(part 1 of 5)
# Autodesk Inventor assembly: ASSEMBLY_DUT_Ant_Rotator_REVB
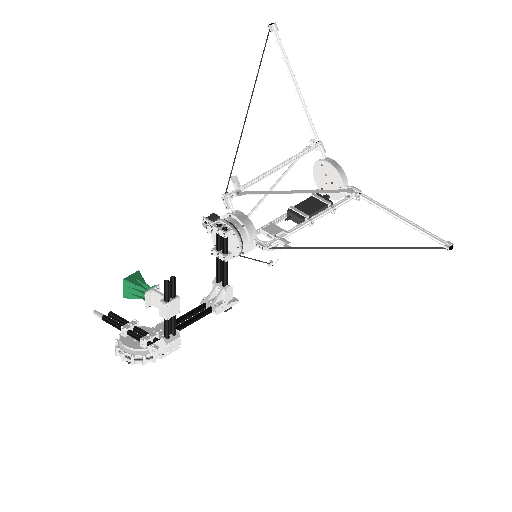
[picture p0: Inventor's stored thumbnail of the model, 512x512]
Saved by Autodesk Inventor 2027 (Build 310192060, 192F)
## iProperties
Created: 2026-01-06
Part Number: ASSEMBLY_DUT_Ant_Rotator_REVB
Document SubType Name: Assembly
Designer: User
Author: User
## Documents named in this file (105)
- C:\Users\lacze\OneDrive\_DRIVE_SYNCH_FILES\RF - Antenna Positioner\MCAD\1_V1\ASSEMBLY_DUT_ANT_POSITIONER_REVB\ASSEMBLY_DUT_Ant_Positioner_REVB.iam
- C:\Users\lacze\OneDrive\_DRIVE_SYNCH_FILES\RF - Antenna Positioner\MCAD\1_V1\__COTS_PARTS\COTS_CARBONCENTER_Fiberglass_Tube_27x24x383mm.ipt
- C:\Users\lacze\OneDrive\_DRIVE_SYNCH_FILES\RF - Antenna Positioner\MCAD\1_V1\__COTS_PARTS\COTS_GENERIC_6020_2RS_150x100x24mm_Ball_Bearing\COTS_GENERIC_6020_2RS_150x100x24mm_Ball_Bearing.ipt
- C:\Users\lacze\OneDrive\_DRIVE_SYNCH_FILES\RF - Antenna Positioner\MCAD\1_V1\ASSEMBLY_DUT_ANT_POSITIONER_REVA\3DP_PLA_A_Axis_Bearing_Base.ipt
- C:\Users\lacze\OneDrive\_DRIVE_SYNCH_FILES\RF - Antenna Positioner\MCAD\1_V1\ASSEMBLY_DUT_ANT_POSITIONER_REVA\3DP_PLA_A_Axis_Bearing_Base_Bearing_Locking_Ring.ipt
- C:\Users\lacze\OneDrive\_DRIVE_SYNCH_FILES\RF - Antenna Positioner\MCAD\1_V1\__CONTENT_CENTER_PARTS\en-US\ISO 7380-1\ISO 7380-1 - M4 x 40.ipt
- C:\Users\lacze\OneDrive\_DRIVE_SYNCH_FILES\RF - Antenna Positioner\MCAD\1_V1\__CONTENT_CENTER_PARTS\en-US\DIN 934\DIN 934 - M4 x 0,7.ipt
- C:\Users\lacze\OneDrive\_DRIVE_SYNCH_FILES\RF - Antenna Positioner\MCAD\1_V1\ASSEMBLY_DUT_ANT_POSITIONER_REVA\3DP_PLA_A_Axis_Rotating_Stage.ipt
- C:\Users\lacze\OneDrive\_DRIVE_SYNCH_FILES\RF - Antenna Positioner\MCAD\1_V1\ASSEMBLY_DUT_ANT_POSITIONER_REVA\3DP_PLA_A_Axis_Rotating_Stage_Mounting_Plate.ipt
- C:\Users\lacze\OneDrive\_DRIVE_SYNCH_FILES\RF - Antenna Positioner\MCAD\1_V1\__CONTENT_CENTER_PARTS\en-US\DIN 912\DIN 912 - M5 x 0,8 x 50 x 22.ipt
- C:\Users\lacze\OneDrive\_DRIVE_SYNCH_FILES\RF - Antenna Positioner\MCAD\1_V1\__CONTENT_CENTER_PARTS\en-US\DIN 934\DIN 934 - M5 x 0,8.ipt
- C:\Users\lacze\OneDrive\_DRIVE_SYNCH_FILES\RF - Antenna Positioner\MCAD\1_V1\__COTS_PARTS\COTS_GENERIC_HTD3M_24T_6mm_5mm_shaft_pulley.ipt
- C:\Users\lacze\OneDrive\_DRIVE_SYNCH_FILES\RF - Antenna Positioner\MCAD\1_V1\__COTS_PARTS\COTS_GENERIC_HTD3M_6mm_675mm_Closed_belt_A_Axis.ipt
- C:\Users\lacze\OneDrive\_DRIVE_SYNCH_FILES\RF - Antenna Positioner\MCAD\1_V1\ASSEMBLY_DUT_ANT_POSITIONER_REVA\ASSEMBLY_HTD3M_Idler_A_Axis.iam
- C:\Users\lacze\OneDrive\_DRIVE_SYNCH_FILES\RF - Antenna Positioner\MCAD\1_V1\__CONTENT_CENTER_PARTS\en-US\DIN 125-1  A\DIN 125 - A 3,2.ipt
- C:\Users\lacze\OneDrive\_DRIVE_SYNCH_FILES\RF - Antenna Positioner\MCAD\1_V1\__CONTENT_CENTER_PARTS\en-US\ISO 7380-1\ISO 7380-1 - M3 x 16.ipt
- C:\Users\lacze\OneDrive\_DRIVE_SYNCH_FILES\RF - Antenna Positioner\MCAD\1_V1\ASSEMBLY_DUT_ANT_POSITIONER_REVA\3DP_PLA_A_Axis_Rotating_Stage_Fiberglass_pipes_mount_plate.ipt
- C:\Users\lacze\OneDrive\_DRIVE_SYNCH_FILES\RF - Antenna Positioner\MCAD\1_V1\ASSEMBLY_DUT_ANT_POSITIONER_REVA\3DP_PLA_A_Axis_Rotating_Stage_Fiberglass_pipes_mount_clamp.ipt
- C:\Users\lacze\OneDrive\_DRIVE_SYNCH_FILES\RF - Antenna Positioner\MCAD\1_V1\__CONTENT_CENTER_PARTS\en-US\DIN 912\DIN 912 - M4 x 0,7 x 20 x 18,25.ipt
- C:\Users\lacze\OneDrive\_DRIVE_SYNCH_FILES\RF - Antenna Positioner\MCAD\1_V1\__COTS_PARTS\COTS_MKS_SERVO42D_40mm.ipt
- C:\Users\lacze\OneDrive\_DRIVE_SYNCH_FILES\RF - Antenna Positioner\MCAD\1_V1\ASSEMBLY_DUT_ANT_POSITIONER_REVA\3DP_PLA_Fiberglass_Pipe_Corner_Bracket.ipt
- C:\Users\lacze\OneDrive\_DRIVE_SYNCH_FILES\RF - Antenna Positioner\MCAD\1_V1\ASSEMBLY_DUT_ANT_POSITIONER_REVA\3DP_PLA_Fiberglass_Pipe_Corner_Bracket_Clamp.ipt
- C:\Users\lacze\OneDrive\_DRIVE_SYNCH_FILES\RF - Antenna Positioner\MCAD\1_V1\__COTS_PARTS\COTS_DREMEC_8G206M6X50_M6x50_Nylon_Screw.ipt
- COTS_DREMEC_8G206M6X50_M6x50_Nylon_Screw.ipt
- C:\Users\lacze\OneDrive\_DRIVE_SYNCH_FILES\RF - Antenna Positioner\MCAD\1_V1\__COTS_PARTS\COTS_BOSSARD_1400444_M6_Nylon_Nut.ipt
- C:\Users\lacze\OneDrive\_DRIVE_SYNCH_FILES\RF - Antenna Positioner\MCAD\1_V1\__COTS_PARTS\COTS_GENERIC_HTD3M_20T_6mm_5mm_shaft_pulley.ipt
- C:\Users\lacze\OneDrive\_DRIVE_SYNCH_FILES\RF - Antenna Positioner\MCAD\1_V1\ASSEMBLY_DUT_ANT_POSITIONER_REVA\3DP_PLA_B_Axis_Main_Pulley.ipt
- C:\Users\lacze\OneDrive\_DRIVE_SYNCH_FILES\RF - Antenna Positioner\MCAD\1_V1\ASSEMBLY_DUT_ANT_POSITIONER_REVA\ASSEMBLY_HTD3M_Idler_B_Axis.iam
- C:\Users\lacze\OneDrive\_DRIVE_SYNCH_FILES\RF - Antenna Positioner\MCAD\1_V1\__COTS_PARTS\COTS_GENERIC_HTD3M_6mm_1530mm_Closed_belt_B_Axis.ipt
- C:\Users\lacze\OneDrive\_DRIVE_SYNCH_FILES\RF - Antenna Positioner\MCAD\1_V1\__CONTENT_CENTER_PARTS\en-US\DIN 912\DIN 912 - M4 x 0,7 x 35 x 20.ipt
- C:\Users\lacze\OneDrive\_DRIVE_SYNCH_FILES\RF - Antenna Positioner\MCAD\1_V1\__COTS_PARTS\COTS_GENERIC_6016_80x125x22mm_POM_Ball_Bearing\COTS_GENERIC_6016_80x125x22mm_POM_Ball_Bearing.ipt
- C:\Users\lacze\OneDrive\_DRIVE_SYNCH_FILES\RF - Antenna Positioner\MCAD\1_V1\ASSEMBLY_DUT_ANT_POSITIONER_REVA\3DP_PLA_B_Axis_Bearing_Mounting_Plate.ipt
- C:\Users\lacze\OneDrive\_DRIVE_SYNCH_FILES\RF - Antenna Positioner\MCAD\1_V1\ASSEMBLY_DUT_ANT_POSITIONER_REVA\ASSEMBLY_HTD3M_Idler_B_Axis_Top.iam
- C:\Users\lacze\OneDrive\_DRIVE_SYNCH_FILES\RF - Antenna Positioner\MCAD\1_V1\__COTS_PARTS\COTS_DREMEC_8G206V50126_M4x40_Nylon_Screw.ipt
- C:\Users\lacze\OneDrive\_DRIVE_SYNCH_FILES\RF - Antenna Positioner\MCAD\1_V1\__COTS_PARTS\COTS_BOSSARD_1400428_M4_Nylon_Nut.ipt
- C:\Users\lacze\OneDrive\_DRIVE_SYNCH_FILES\RF - Antenna Positioner\MCAD\1_V1\ASSEMBLY_DUT_ANT_POSITIONER_REVA\3DP_PLA_B_Axis_Rotating_Stage.ipt
- C:\Users\lacze\OneDrive\_DRIVE_SYNCH_FILES\RF - Antenna Positioner\MCAD\1_V1\__COTS_PARTS\COTS_BYTECHLAB_COAXIAL_FEED_HORN\COTS_BYTECHLAB_Coaxial_Feed_Horn.iam
- C:\Users\lacze\OneDrive\_DRIVE_SYNCH_FILES\RF - Antenna Positioner\MCAD\1_V1\ASSEMBLY_DUT_ANT_POSITIONER_REVA\3DP_PLA_B_Axis_Rotating_Stage_Fiberglass_pipes_mount_clamp.ipt
- C:\Users\lacze\OneDrive\_DRIVE_SYNCH_FILES\RF - Antenna Positioner\MCAD\1_V1\ASSEMBLY_DUT_ANT_POSITIONER_REVA\3DP_PLA_B_Axis_End_Cap.ipt
- C:\Users\lacze\OneDrive\_DRIVE_SYNCH_FILES\RF - Antenna Positioner\MCAD\1_V1\ASSEMBLY_DUT_ANT_POSITIONER_REVA\3DP_PLA_Antenna_Boom_Fiberglass_Pipe_Clamp.ipt
- C:\Users\lacze\OneDrive\_DRIVE_SYNCH_FILES\RF - Antenna Positioner\MCAD\1_V1\__COTS_PARTS\COTS_Profihot_HC-2-22x16_Zip_Tie_Anchor.ipt
- C:\Users\lacze\OneDrive\_DRIVE_SYNCH_FILES\RF - Antenna Positioner\MCAD\1_V1\__COTS_PARTS\COTS_BOSSARD_1386883_M4_Threaded_Insert\COTS_BOSSARD_1386883_M4_Threaded_Insert.ipt
- C:\Users\lacze\OneDrive\_DRIVE_SYNCH_FILES\RF - Antenna Positioner\MCAD\1_V1\__CONTENT_CENTER_PARTS\en-US\DIN 125-1  A\DIN 125 - A 4,3.ipt
- C:\Users\lacze\OneDrive\_DRIVE_SYNCH_FILES\RF - Antenna Positioner\MCAD\1_V1\__CONTENT_CENTER_PARTS\en-US\ISO 7380-1\ISO 7380-1 - M4 x 8.ipt
- C:\Users\lacze\OneDrive\_DRIVE_SYNCH_FILES\RF - Antenna Positioner\MCAD\1_V1\__CONTENT_CENTER_PARTS\en-US\ISO 7380-1\ISO 7380-1 - M4 x 16.ipt
- C:\Users\lacze\OneDrive\_DRIVE_SYNCH_FILES\RF - Antenna Positioner\MCAD\1_V1\__COTS_PARTS\COTS_DREMEC_8G206M5X08_M5x8_Nylon_Screw.ipt
- C:\Users\lacze\OneDrive\_DRIVE_SYNCH_FILES\RF - Antenna Positioner\MCAD\1_V1\ASSEMBLY_DUT_ANT_POSITIONER_REVA\3DP_PLA_B_Axis_Cable_Galnd.ipt
- C:\Users\lacze\OneDrive\_DRIVE_SYNCH_FILES\RF - Antenna Positioner\MCAD\1_V1\ASSEMBLY_DUT_ANT_POSITIONER_REVA\3DP_PLA_A_Axis_Idler_Stiffening_Bracket.ipt
- C:\Users\lacze\OneDrive\_DRIVE_SYNCH_FILES\RF - Antenna Positioner\MCAD\1_V1\ASSEMBLY_DUT_ANT_POSITIONER_REVA\3DP_PLA_B_Axis_Idler_Stiffening_Bracket.ipt
- C:\Users\lacze\OneDrive\_DRIVE_SYNCH_FILES\RF - Antenna Positioner\MCAD\1_V1\ASSEMBLY_DUT_ANT_POSITIONER_REVB\3DP_PLA_Antenna_Boom_Coax_Feed_Horn_REVB.ipt
- C:\Users\lacze\OneDrive\_DRIVE_SYNCH_FILES\RF - Antenna Positioner\MCAD\1_V1\ASSEMBLY_DUT_ANT_POSITIONER_REVB\3DP_PLA_A_Axis_Bearing_Base_Stand_Mount_REVB.ipt
- C:\Users\lacze\OneDrive\_DRIVE_SYNCH_FILES\RF - Antenna Positioner\MCAD\1_V1\__COTS_PARTS\COTS_Fleximo_FB12020_20x20_Alu_Profile_150mm.ipt
- C:\Users\lacze\OneDrive\_DRIVE_SYNCH_FILES\RF - Antenna Positioner\MCAD\1_V1\__COTS_PARTS\COTS_Fleximo_FB12020_20x20_Alu_Profile_600mm.ipt
- C:\Users\lacze\OneDrive\_DRIVE_SYNCH_FILES\RF - Antenna Positioner\MCAD\1_V1\__COTS_PARTS\COTS_Fleximo_FB1K2020_Angle\COTS_Fleximo_FB1K2020_Angle.ipt
- C:\Users\lacze\OneDrive\_DRIVE_SYNCH_FILES\RF - Antenna Positioner\MCAD\1_V1\__COTS_PARTS\COTS_Fleximo_FB1ZP20C_20x20_End_Cap\COTS_Fleximo_FB1ZP20C_20x20_End_Cap.ipt
- C:\Users\lacze\OneDrive\_DRIVE_SYNCH_FILES\RF - Antenna Positioner\MCAD\1_V1\__COTS_PARTS\COTS_Fleximo_FB12020_20x20_Alu_Profile_575mm.ipt
- C:\Users\lacze\OneDrive\_DRIVE_SYNCH_FILES\RF - Antenna Positioner\MCAD\1_V1\__COTS_PARTS\COTS_Fleximo_FBP2020_20x20_Hinge\COTS_Fleximo_FBP2020_20x20_Hinge.ipt
- C:\Users\lacze\OneDrive\_DRIVE_SYNCH_FILES\RF - Antenna Positioner\MCAD\1_V1\__COTS_PARTS\COTS_GENERIC_5mm_Carbon_Rod.ipt
- C:\Users\lacze\OneDrive\_DRIVE_SYNCH_FILES\RF - Antenna Positioner\MCAD\1_V1\__COTS_PARTS\COTS_Fleximo_FB1NM3_M3_Nut_20x20\COTS_Fleximo_FB1NM3_M3_Nut_20x20.ipt
- C:\Users\lacze\OneDrive\_DRIVE_SYNCH_FILES\RF - Antenna Positioner\MCAD\1_V1\__CONTENT_CENTER_PARTS\en-US\ISO 7380-1\ISO 7380-1 - M3 x 12.ipt
- C:\Users\lacze\OneDrive\_DRIVE_SYNCH_FILES\RF - Antenna Positioner\MCAD\1_V1\__CONTENT_CENTER_PARTS\en-US\DIN 125-1  A\DIN 125 - A 5,3.ipt
- C:\Users\lacze\OneDrive\_DRIVE_SYNCH_FILES\RF - Antenna Positioner\MCAD\1_V1\__CONTENT_CENTER_PARTS\en-US\DIN 912\DIN 912 - M5 x 0,8 x 30 x 22.ipt
- C:\Users\lacze\OneDrive\_DRIVE_SYNCH_FILES\RF - Antenna Positioner\MCAD\1_V1\ASSEMBLY_DUT_ANT_POSITIONER_REVB\3DP_PLA_A_Axis_Bearing_Base_Stand_Mount_Bottom_REVB.ipt
- C:\Users\lacze\OneDrive\_DRIVE_SYNCH_FILES\RF - Antenna Positioner\MCAD\1_V1\__COTS_PARTS\COTS_Fleximo_FB1NM4_M4_Nut_20x20\COTS_Fleximo_FB1NM4_M4_Nut_20x20.ipt
- C:\Users\lacze\OneDrive\_DRIVE_SYNCH_FILES\RF - Antenna Positioner\MCAD\1_V1\__CONTENT_CENTER_PARTS\en-US\DIN 912\DIN 912 - M4 x 0,7 x 10 x 8,25.ipt
- C:\Users\lacze\OneDrive\_DRIVE_SYNCH_FILES\RF - Antenna Positioner\MCAD\1_V1\__CONTENT_CENTER_PARTS\en-US\DIN 912\DIN 912 - M4 x 0,7 x 16 x 14,25.ipt
- C:\Users\lacze\OneDrive\_DRIVE_SYNCH_FILES\RF - Antenna Positioner\MCAD\1_V1\ASSEMBLY_DUT_ANT_POSITIONER_REVB\3DP_PLA_A_Axis_Bearing_Base_Stand_Bottom_Plate_REVB.ipt
- C:\Users\lacze\OneDrive\_DRIVE_SYNCH_FILES\RF - Antenna Positioner\MCAD\1_V1\ASSEMBLY_DUT_ANT_POSITIONER_REVB\3DP_PLA_Foldable_Leg_Brace_Mount_REVB.ipt
- C:\Users\lacze\OneDrive\_DRIVE_SYNCH_FILES\RF - Antenna Positioner\MCAD\1_V1\ASSEMBLY_DUT_ANT_POSITIONER_REVB\3DP_PLA_A_Axis_Stepper_Mount_REVB.ipt
- C:\Users\lacze\OneDrive\_DRIVE_SYNCH_FILES\RF - Antenna Positioner\MCAD\1_V1\__COTS_PARTS\COTS_GENERIC_24V_Power_Brick.ipt
- C:\Users\lacze\OneDrive\_DRIVE_SYNCH_FILES\RF - Antenna Positioner\MCAD\1_V1\ASSEMBLY_DUT_ANT_POSITIONER_REVB\3DP_PLA_Power_Brick_Mounting_Clamp_REVB.ipt
- C:\Users\lacze\OneDrive\_DRIVE_SYNCH_FILES\RF - Antenna Positioner\MCAD\1_V1\ASSEMBLY_DUT_ANT_POSITIONER_REVB\3DP_PLA_Fiberglass_Pipe_Corner_Bracket_Clamp_and_B_axis_Stepper_Mount_REVB.ipt
- C:\Users\lacze\OneDrive\_DRIVE_SYNCH_FILES\RF - Antenna Positioner\MCAD\1_V1\ASSEMBLY_DUT_ANT_POSITIONER_REVB\3DP_PLA_Alu_Frame_Brace_REVB.ipt
- C:\Users\lacze\OneDrive\_DRIVE_SYNCH_FILES\RF - Antenna Positioner\MCAD\1_V1\ASSEMBLY_DUT_ANT_POSITIONER_REVB\LC_3mm_ALU_Alu_Frame_Brace_REVB.ipt
- C:\Users\lacze\OneDrive\_DRIVE_SYNCH_FILES\RF - Antenna Positioner\MCAD\1_V1\__CONTENT_CENTER_PARTS\en-US\DIN 912\DIN 912 - M4 x 0,7 x 25 x 23,25.ipt
- C:\Users\lacze\OneDrive\_DRIVE_SYNCH_FILES\RF - Antenna Positioner\MCAD\1_V1\ASSEMBLY_DUT_ANT_POSITIONER_REVB\3DP_PLA_Folded_Leg_Holder_REVB.ipt
- C:\Users\lacze\OneDrive\_DRIVE_SYNCH_FILES\RF - Antenna Positioner\MCAD\1_V1\ASSEMBLY_DUT_ANT_POSITIONER_REVB\3DP_PLA_Carbon_Rod_Holder_Top_REVB.ipt
- C:\Users\lacze\OneDrive\_DRIVE_SYNCH_FILES\RF - Antenna Positioner\MCAD\1_V1\ASSEMBLY_DUT_ANT_POSITIONER_REVB\3DP_PLA_Carbon_Rod_Holder_Bottom_REVB.ipt
- C:\Users\lacze\OneDrive\_DRIVE_SYNCH_FILES\RF - Antenna Positioner\MCAD\1_V1\ASSEMBLY_DUT_ANT_POSITIONER_REVB\3DP_PLA_Frame_Stiffener_and_Leg_REVB.ipt
- C:\Users\lacze\OneDrive\_DRIVE_SYNCH_FILES\RF - Antenna Positioner\MCAD\1_V1\__CONTENT_CENTER_PARTS\en-US\ISO 7380-1\ISO 7380-1 - M6 x 16.ipt
- C:\Users\lacze\OneDrive\_DRIVE_SYNCH_FILES\RF - Antenna Positioner\MCAD\1_V1\__CONTENT_CENTER_PARTS\en-US\ISO 7380-1\ISO 7380-1 - M5 x 8.ipt
- C:\Users\lacze\OneDrive\_DRIVE_SYNCH_FILES\RF - Antenna Positioner\MCAD\1_V1\ASSEMBLY_DUT_ANT_POSITIONER_REVB\3DP_PLA_Frame_Leg_Leg_REVB.ipt
- C:\Users\lacze\OneDrive\_DRIVE_SYNCH_FILES\RF - Antenna Positioner\MCAD\1_V1\ASSEMBLY_DUT_ANT_POSITIONER_REVB\3DP_PLA_Electronics_Box_Bottom_REVB.ipt
- C:\Users\lacze\OneDrive\_DRIVE_SYNCH_FILES\RF - Antenna Positioner\MCAD\1_V1\__KICAD_PCB_PARTS\1_SERVO_CONN_PCB\ASSEMBLY_PCB_SERVO_CONN.iam
- C:\Users\lacze\OneDrive\_DRIVE_SYNCH_FILES\RF - Antenna Positioner\MCAD\1_V1\__COTS_PARTS\COTS_MKS_Canable_2_0.ipt
- C:\Users\lacze\OneDrive\_DRIVE_SYNCH_FILES\RF - Antenna Positioner\MCAD\1_V1\ASSEMBLY_DUT_ANT_POSITIONER_REVB\3DP_PLA_Electronics_Box_Top_REVB.ipt
- C:\Users\lacze\OneDrive\_DRIVE_SYNCH_FILES\RF - Antenna Positioner\MCAD\1_V1\__CONTENT_CENTER_PARTS\en-US\ISO 7380-1\ISO 7380-1 - M3 x 6.ipt
- C:\Users\lacze\OneDrive\_DRIVE_SYNCH_FILES\RF - Antenna Positioner\MCAD\1_V1\__CONTENT_CENTER_PARTS\en-US\DIN 912\DIN 912 - M2 x 0,4 x 6 x 5.ipt
- C:\Users\lacze\OneDrive\_DRIVE_SYNCH_FILES\RF - Antenna Positioner\MCAD\1_V1\__CONTENT_CENTER_PARTS\en-US\DIN 912\DIN 912 - M3 x 0,5 x 30 x 18.ipt
- C:\Users\lacze\OneDrive\_DRIVE_SYNCH_FILES\RF - Antenna Positioner\MCAD\1_V1\__CONTENT_CENTER_PARTS\en-US\DIN 934\DIN 934 - M3 x 0,5.ipt
- C:\Users\lacze\OneDrive\_DRIVE_SYNCH_FILES\RF - Antenna Positioner\MCAD\1_V1\__CONTENT_CENTER_PARTS\en-US\DIN 912\DIN 912 - M3 x 0,5 x 8 x 6,75.ipt
- C:\Users\lacze\OneDrive\_DRIVE_SYNCH_FILES\RF - Antenna Positioner\MCAD\1_V1\__COTS_PARTS\COTS_BYTECHLAB_DUAL_RIDGED_HORN_3D_PRINTED\COTS_BYTECHLAB_Dual_Ridged_Horn.iam
- C:\Users\lacze\OneDrive\_DRIVE_SYNCH_FILES\RF - Antenna Positioner\MCAD\1_V1\ASSEMBLY_DUT_ANT_POSITIONER_REVB\3DP_PLA_Antenna_Boom_Dual_Ridged_Horn_3DP_REVB.ipt
- C:\Users\lacze\OneDrive\_DRIVE_SYNCH_FILES\RF - Antenna Positioner\MCAD\1_V1\ASSEMBLY_DUT_ANT_POSITIONER_REVB\3DP_PLA_Antenna_Boom_High_Frequency_Biconical_REVB.ipt
- C:\Users\lacze\OneDrive\_DRIVE_SYNCH_FILES\RF - Antenna Positioner\MCAD\1_V1\__COTS_PARTS\COTS_BYTECHLAB_HIGH_FREQ_BICONICAL\COTS_BYTECHLAB_High_Freq_Biconical.iam
- C:\Users\lacze\OneDrive\_DRIVE_SYNCH_FILES\RF - Antenna Positioner\MCAD\1_V1\__COTS_PARTS\COTS_BYTACHLAB_MICROSTRIP_PATCH_ARRAY\COTS_BYTECHLAB_Microstrip_Patch_Array.iam
- C:\Users\lacze\OneDrive\_DRIVE_SYNCH_FILES\RF - Antenna Positioner\MCAD\1_V1\ASSEMBLY_DUT_ANT_POSITIONER_REVB\3DP_PLA_Antenna_Boom_Microstrip_Patch_Array_REVB.ipt
- C:\Users\lacze\OneDrive\_DRIVE_SYNCH_FILES\RF - Antenna Positioner\MCAD\1_V1\__COTS_PARTS\COTS_BYTECHLAB_2_4_GHz_2x2_PHASED_ARRAY\COTS_BYTECHLAB_2_4_GHz_2x2_Phased_Array.iam
- C:\Users\lacze\OneDrive\_DRIVE_SYNCH_FILES\RF - Antenna Positioner\MCAD\1_V1\ASSEMBLY_DUT_ANT_POSITIONER_REVB\3DP_PLA_Antenna_Boom_2_4GHz_2x2_Phased_Array_REVB.ipt
- C:\Users\lacze\OneDrive\_DRIVE_SYNCH_FILES\RF - Antenna Positioner\MCAD\1_V1\__COTS_PARTS\COTS_BYTECHLAB_LOG_PERIODIC\COTS_BYTECHLAB_Log_Periodic.iam
- C:\Users\lacze\OneDrive\_DRIVE_SYNCH_FILES\RF - Antenna Positioner\MCAD\1_V1\ASSEMBLY_DUT_ANT_POSITIONER_REVB\3DP_PLA_Antenna_Boom_Log_Periodic_REVB.ipt
- C:\Users\lacze\OneDrive\_DRIVE_SYNCH_FILES\RF - Antenna Positioner\MCAD\1_V1\ASSEMBLY_DUT_ANT_POSITIONER_REVB\3DP_PLA_Antenna_Boom_Log_Periodic_Clamp_REVB.ipt
- C:\Users\lacze\OneDrive\_DRIVE_SYNCH_FILES\RF - Antenna Positioner\MCAD\1_V1\__COTS_PARTS\COTS_BYTECHLAB_ANTIPODAL_VIVALDI\COTS_BYTECHLAB_Antipodal_Vivaldi.iam
- C:\Users\lacze\OneDrive\_DRIVE_SYNCH_FILES\RF - Antenna Positioner\MCAD\1_V1\ASSEMBLY_DUT_ANT_POSITIONER_REVB\3DP_PLA_Antenna_Boom_Antipodal_Vivaldi_REVB.ipt
- C:\Users\lacze\OneDrive\_DRIVE_SYNCH_FILES\RF - Antenna Positioner\MCAD\1_V1\ASSEMBLY_DUT_ANT_POSITIONER_REVB\3DP_PLA_Antenna_Boom_Clamp_Antipodal_Vivaldi_REVB.ipt
## Components (597 placed, 103 different names)
1. COTS_CARBONCENTER_Fiberglass_Tube_27x24x383mm:1 — Mate:124, Flush:1, Mate:210, Mate:214
2. COTS_GENERIC_6020_2RS_150x100x24mm_Ball_Bearing:1 — Mate:3, Mate:4, Mate:40, Mate:41, Mate:42, Mate:43
3. 3DP_PLA_A_Axis_Bearing_Base:1 — Mate:1, Mate:2, Mate:3, Mate:4, Mate:5, Mate:6, Mate:7, Mate:25, Mate:27, Mate:29, Mate:31, Mate:33, Mate:35, Mate:37, Mate:39, Angle:1, Angle:2, Angle:3, Angle:4, Angle:5, Angle:6, Angle:7, Angle:8, Angle:17, Mate:80, Mate:81, Mate:82, Mate:90, Mate:92, Mate:94, Angle:18, Angle:19, Angle:20, Mate:576, Angle:64, Mate:577, Flush:24, Mate:625, Mate:627, Mate:781, Mate:782, Mate:783, Mate:784, Mate:785, Mate:786, Mate:787, Mate:788, Mate:789, Mate:790, Mate:791, Mate:792, Mate:793, Mate:794, Mate:796, Mate:798, Mate:800, Mate:802, Mate:804
4. 3DP_PLA_A_Axis_Bearing_Base_Bearing_Locking_Ring:1 — Mate:5, Mate:6, Mate:7, Mate:8, Mate:9, Mate:10, Mate:11, Mate:12, Mate:13, Mate:14, Mate:15, Mate:16, Mate:17, Mate:18, Mate:19, Mate:20, Mate:21, Mate:22, Mate:23, Mate:24, Mate:26, Mate:28, Mate:30, Mate:32, Mate:34, Mate:36, Mate:38
5. COTS_MKS_SERVO42D_40mm:1 — Mate:77, Mate:107, Mate:108, Mate:109, Mate:110, Mate:112, Mate:114, Mate:116
6. 3DP_PLA_A_Axis_Rotating_Stage:1 — Mate:40, Mate:41, Mate:44, Mate:45, Mate:46, Mate:47, Mate:48, Mate:49, Mate:50, Mate:51, Mate:52, Mate:53, Mate:54, Mate:55, Mate:56, Mate:57, Mate:58, Mate:59, Mate:60, Mate:61, Mate:63, Mate:65, Mate:67, Mate:69, Mate:71, Mate:73, Mate:75, Mate:78, Mate:79, Mate:121, Mate:122, Mate:123, Mate:194, Mate:196, Mate:198, Mate:200, Mate:202, Mate:204, Mate:206, Mate:208, Angle:33, Angle:34, Angle:35, Angle:36, Angle:37, Angle:38, Angle:39, Angle:40
7. 3DP_PLA_A_Axis_Rotating_Stage_Mounting_Plate:1 — Mate:42, Mate:43, Mate:44, Mate:62, Mate:64, Mate:66, Mate:68, Mate:70, Mate:72, Mate:74, Mate:76, Angle:9, Angle:10, Angle:11, Angle:12, Angle:13, Angle:14, Angle:15, Angle:16
8. COTS_GENERIC_HTD3M_24T_6mm_5mm_shaft_pulley:1 — Mate:77, Mate:118, Mate:119
9. COTS_GENERIC_HTD3M_6mm_675mm_Closed_belt_A_Axis:1 — Mate:78, Mate:79, Mate:118, Mate:119
10. 3DP_PLA_A_Axis_Stepper_Mount_REVB:1 — Mate:80, Mate:81, Mate:82, Mate:83, Mate:84, Mate:85, Mate:86, Mate:87, Mate:88, Mate:89, Mate:91, Mate:93, Mate:95, Mate:96, Mate:97, Mate:98, Mate:107, Mate:108, Mate:109, Mate:111, Mate:113, Mate:115, Mate:117, Mate:600, Mate:602
11. ASSEMBLY_HTD3M_Idler_A_Axis:1 [sub-assembly] — Mate:96, Mate:98, Mate:594
12. ASSEMBLY_HTD3M_Idler_A_Axis:2 [sub-assembly] — Mate:95, Mate:97, Mate:592, Mate:593
13. 3DP_PLA_A_Axis_Rotating_Stage_Fiberglass_pipes_mount_plate:1 — Mate:121, Mate:122, Mate:123, Mate:124, Flush:1, Mate:125, Flush:2, Mate:127, Mate:128, Flush:3, Flush:4, Flush:5, Flush:6, Mate:154, Mate:156, Mate:158, Mate:160, Mate:162, Mate:164, Mate:166, Mate:168, Mate:170, Mate:172, Mate:174, Mate:176, Angle:21, Angle:22, Angle:23, Angle:24, Angle:25, Angle:26, Angle:27, Angle:28, Angle:29, Angle:30, Angle:31, Angle:32, Mate:177, Mate:178, Mate:179, Mate:180, Mate:181, Mate:182, Mate:183, Mate:184, Mate:185, Mate:186, Mate:187, Mate:188, Mate:189, Mate:190, Mate:191, Mate:192, Mate:193, Mate:195, Mate:197, Mate:199, Mate:201, Mate:203, Mate:205, Mate:207, Angle:41
14. COTS_CARBONCENTER_Fiberglass_Tube_27x24x383mm:2 — Mate:125, Flush:2, Mate:209, Mate:213, Flush:7
15. COTS_CARBONCENTER_Fiberglass_Tube_27x24x383mm:3 — Mate:211, Mate:240, Mate:242, Angle:42
16. 3DP_PLA_A_Axis_Rotating_Stage_Fiberglass_pipes_mount_clamp:1 — Mate:128, Flush:5, Flush:6, Mate:141, Mate:143, Mate:145, Mate:147, Mate:149, Mate:151, Mate:165, Mate:167, Mate:169, Mate:171, Mate:173, Mate:175
17. 3DP_PLA_A_Axis_Rotating_Stage_Fiberglass_pipes_mount_clamp:2 — Mate:127, Flush:3, Flush:4, Mate:129, Mate:130, Mate:131, Mate:132, Mate:133, Mate:134, Mate:135, Mate:136, Mate:137, Mate:138, Mate:139, Mate:140, Mate:142, Mate:144, Mate:146, Mate:148, Mate:150, Mate:152, Mate:153, Mate:155, Mate:157, Mate:159, Mate:161, Mate:163
18. COTS_CARBONCENTER_Fiberglass_Tube_27x24x383mm:4 — Mate:212, Mate:241, Mate:243, Mate:411
19. COTS_CARBONCENTER_Fiberglass_Tube_27x24x383mm:5 — Mate:251, Mate:254, Flush:11, Mate:406, Flush:19, Mate:407, Mate:409, Mate:590, Mate:591
20. COTS_CARBONCENTER_Fiberglass_Tube_27x24x383mm:6 — Mate:250, Mate:255, Flush:12, Mate:405, Mate:408, Mate:410
21. COTS_CARBONCENTER_Fiberglass_Tube_27x24x383mm:7 — Mate:253, Mate:256, Flush:13, Mate:501, Mate:503
22. COTS_CARBONCENTER_Fiberglass_Tube_27x24x383mm:8 — Mate:252, Mate:257, Flush:14, Mate:500, Flush:22, Mate:502, Mate:958, Mate:962, Mate:965, Mate:968, Mate:971, Mate:977
23. 3DP_PLA_Fiberglass_Pipe_Corner_Bracket:1 — Mate:209, Mate:210, Mate:211, Mate:212, Mate:215, Mate:228, Mate:229, Mate:230, Mate:231, Mate:232, Mate:233, Mate:240, Mate:241, Mate:244, Mate:270, Mate:271, Mate:272, Mate:273, Mate:274, Mate:275
24. 3DP_PLA_Fiberglass_Pipe_Corner_Bracket_Clamp:1 — Mate:213, Mate:214, Mate:215, Mate:216, Mate:217, Mate:218, Mate:219, Mate:220, Mate:221, Mate:222, Mate:223, Mate:224, Mate:225, Mate:226, Mate:227, Flush:7
25. 3DP_PLA_Fiberglass_Pipe_Corner_Bracket_Clamp_and_B_axis_Stepper_Mount_REVB:1 — Mate:242, Mate:243, Mate:244, Mate:245, Mate:248, Mate:249, Flush:8, Mate:258, Mate:259, Mate:260, Mate:261, Mate:262, Mate:263, Mate:264, Mate:265, Mate:266, Mate:267, Mate:268, Mate:269, Mate:331, Mate:332, Mate:333, Mate:334, Mate:336, Mate:342, Mate:344, Mate:346, Mate:348, Angle:43, Mate:581, Mate:582, Mate:584, Mate:585, Mate:611, Mate:613
26. COTS_MKS_SERVO42D_40mm:2 — Mate:245, Mate:247, Mate:248, Mate:249, Mate:336, Mate:341, Mate:343, Mate:345, Mate:347, Angle:65
27. COTS_GENERIC_HTD3M_20T_6mm_5mm_shaft_pulley:1 — Mate:247, Flush:8, Mate:335, Mate:337
28. 3DP_PLA_Fiberglass_Pipe_Corner_Bracket:2 — Mate:250, Mate:251, Mate:252, Mate:253, Flush:9, Flush:10, Mate:306, Mate:307, Mate:308, Mate:309, Mate:310, Mate:311, Mate:312, Mate:313, Mate:314, Mate:315, Mate:316, Mate:317, Angle:54
29. 3DP_PLA_Fiberglass_Pipe_Corner_Bracket_Clamp:2 — Mate:254, Mate:255, Flush:10, Flush:11, Flush:12, Mate:282, Mate:283, Mate:284, Mate:285, Mate:286, Mate:287, Mate:300, Mate:301, Mate:302, Mate:303, Mate:304, Mate:305
30. 3DP_PLA_Fiberglass_Pipe_Corner_Bracket_Clamp:3 — Mate:256, Mate:257, Flush:9, Flush:13, Flush:14, Mate:288, Mate:289, Mate:290, Mate:291, Mate:292, Mate:293, Mate:294, Mate:295, Mate:296, Mate:297, Mate:298, Mate:299
31. 3DP_PLA_B_Axis_Main_Pulley:1 — Mate:339, Mate:340, Mate:357, Mate:358, Mate:359, Mate:360, Mate:404, Mate:460, Mate:461, Mate:462, Mate:463, Mate:464, Mate:465, Mate:466, Mate:467, Mate:468, Mate:469, Mate:470, Mate:471, Mate:472, Mate:486, Mate:487, Mate:488, Mate:489, Mate:490, Mate:491, Mate:492, Mate:493
32. ASSEMBLY_HTD3M_Idler_B_Axis:1 [sub-assembly] — Mate:331, Mate:334, Mate:605
33. ASSEMBLY_HTD3M_Idler_B_Axis:2 [sub-assembly] — Mate:332, Mate:333, Mate:603, Mate:604
34. COTS_GENERIC_HTD3M_6mm_1530mm_Closed_belt_B_Axis:1 — Mate:335, Mate:337, Mate:339, Mate:340, Angle:42
35. COTS_GENERIC_6016_80x125x22mm_POM_Ball_Bearing:1 — Mate:357, Mate:358, Flush:17, Mate:362, Mate:485
36. COTS_GENERIC_6016_80x125x22mm_POM_Ball_Bearing:2 — Mate:359, Mate:360, Mate:361, Flush:16, Mate:403
37. 3DP_PLA_B_Axis_Bearing_Mounting_Plate:1 — Mate:361, Flush:16, Angle:43, Flush:18, Mate:363, Mate:364, Mate:365, Mate:366, Mate:367, Mate:368, Mate:369, Mate:370, Mate:383, Mate:384, Mate:385, Mate:386, Mate:387, Mate:388, Mate:397, Mate:411, Angle:54
38. 3DP_PLA_B_Axis_Bearing_Mounting_Plate:2 — Flush:17, Mate:362, Flush:18, Mate:371, Mate:372, Mate:373, Mate:374, Mate:375, Mate:376, Mate:377, Mate:378, Mate:379, Mate:380, Mate:381, Mate:382, Mate:395, Mate:396, Mate:399, Mate:400, Mate:586, Angle:66, Mate:587, Mate:588
39. ASSEMBLY_HTD3M_Idler_B_Axis_Top:1 [sub-assembly] — Mate:363, Mate:365
40. ASSEMBLY_HTD3M_Idler_B_Axis_Top:2 [sub-assembly] — Mate:364, Mate:366
41. 3DP_PLA_B_Axis_Rotating_Stage:1 — Mate:403, Mate:404, Mate:405, Mate:406, Flush:19, Flush:20, Flush:21, Mate:436, Mate:437, Mate:438, Mate:439, Mate:440, Mate:441, Mate:442, Mate:443, Mate:444, Mate:445, Mate:446, Mate:447, Angle:44, Angle:45, Angle:46, Angle:47, Angle:48, Angle:49, Angle:50, Angle:51, Angle:52, Angle:53, Mate:460, Mate:473, Mate:474, Mate:475, Mate:476, Mate:477, Mate:478, Angle:55, Angle:56, Angle:57, Angle:58, Angle:59, Angle:60
42. 3DP_PLA_B_Axis_Rotating_Stage_Fiberglass_pipes_mount_clamp:1 — Mate:407, Mate:408, Flush:20, Mate:412, Mate:413, Mate:414, Mate:415, Mate:416, Mate:417, Mate:430, Mate:431, Mate:432, Mate:433, Mate:434, Mate:435
43. 3DP_PLA_B_Axis_Rotating_Stage_Fiberglass_pipes_mount_clamp:2 — Mate:409, Mate:410, Flush:21, Mate:418, Mate:419, Mate:420, Mate:421, Mate:422, Mate:423, Mate:424, Mate:425, Mate:426, Mate:427, Mate:428, Mate:429
44. 3DP_PLA_B_Axis_End_Cap:1 — Mate:485, Mate:486, Mate:487, Mate:494, Mate:495, Mate:496, Angle:61, Angle:62, Angle:63
45. 3DP_PLA_Antenna_Boom_Fiberglass_Pipe_Clamp:1 — Mate:502, Mate:503, Flush:23, Mate:512, Mate:513, Mate:514, Mate:515, Flush:63, Flush:64, Flush:65, Flush:66, Flush:67, Flush:68, Flush:69, Flush:70, Flush:71, Flush:72, Flush:74, Flush:75
46. COTS_Profihot_HC-2-22x16_Zip_Tie_Anchor:1 — Mate:576, Angle:64, Mate:578, Mate:579, Mate:580
47. COTS_Profihot_HC-2-22x16_Zip_Tie_Anchor:2 — Mate:581, Angle:65, Mate:583
48. COTS_Profihot_HC-2-22x16_Zip_Tie_Anchor:3 — Mate:586, Angle:66, Mate:587, Mate:589
49. COTS_DREMEC_8G206M5X08_M5x8_Nylon_Screw:1 — Mate:588, Mate:589
50. 3DP_PLA_B_Axis_Cable_Galnd:1 — Mate:590, Mate:591
51. 3DP_PLA_A_Axis_Idler_Stiffening_Bracket:1 — Mate:592, Mate:593, Mate:594, Mate:595, Mate:596, Mate:597, Mate:598, Mate:599, Mate:601
52. 3DP_PLA_B_Axis_Idler_Stiffening_Bracket:1 — Mate:603, Mate:604, Mate:605, Mate:606, Mate:607, Mate:608, Mate:609, Mate:610, Mate:612
53. 3DP_PLA_A_Axis_Bearing_Base_Stand_Mount_REVB:1 — Mate:625, Mate:627, Mate:629, Mate:630, Mate:690, Mate:751, Mate:753, Mate:755, Mate:757, Mate:759, Mate:761, Mate:763, Mate:765, Mate:767, Mate:781, Mate:795, Mate:797, Mate:799, Mate:801, Mate:803, Mate:805
54. 3DP_PLA_A_Axis_Bearing_Base_Stand_Mount_Bottom_REVB:1 — Mate:691, Mate:730, Mate:731, Mate:732, Mate:733, Mate:734, Mate:735, Mate:736, Mate:737, Mate:738, Mate:739, Mate:740, Mate:741, Mate:742, Mate:743, Mate:744, Mate:745, Mate:746, Mate:747, Mate:748, Mate:749, Mate:750, Mate:752, Mate:754, Mate:756, Mate:758, Mate:760, Mate:762, Mate:764, Mate:766, Mate:768, Mate:769
55. 3DP_PLA_A_Axis_Bearing_Base_Stand_Bottom_Plate_REVB:1 — Mate:770, Mate:771, Mate:772, Mate:775, Mate:776, Mate:777, Mate:778, Mate:779, Mate:780
56. COTS_GENERIC_24V_Power_Brick:1 — Mate:827, Mate:828, Flush:45
57. 3DP_PLA_Power_Brick_Mounting_Clamp_REVB:1 — Mate:818, Flush:44, Mate:826, Mate:828, Mate:829, Flush:45, Mate:831, Mate:832, Mate:834, Mate:836, Mate:837, Mate:838, Mate:839, Mate:845, Mate:847, Mate:848, Mate:850
58. 3DP_PLA_Power_Brick_Mounting_Clamp_REVB:2 — Mate:819, Mate:825, Flush:43, Mate:829, Mate:830, Mate:833, Mate:835, Mate:841, Mate:843, Mate:849
59. 3DP_PLA_Power_Brick_Mounting_Clamp_REVB:3 — Mate:820, Mate:824, Flush:43, Mate:853
60. 3DP_PLA_Power_Brick_Mounting_Clamp_REVB:4 — Mate:821, Mate:822, Flush:44, Mate:827, Mate:840, Mate:842, Mate:844, Mate:846, Mate:851, Mate:852, Mate:854
61. 3DP_PLA_Carbon_Rod_Holder_Bottom_REVB:1 — Mate:880, Flush:50, Flush:51, Mate:886, Mate:888
62. 3DP_PLA_Carbon_Rod_Holder_Top_REVB:1 — Mate:881, Flush:52, Flush:53, Mate:882, Mate:883, Mate:884, Mate:885, Mate:887, Mate:889
63. 3DP_PLA_Electronics_Box_Bottom_REVB:1 — Mate:909, Mate:910, Mate:911, Mate:912, Mate:913, Mate:914, Mate:915, Mate:916, Flush:60, Mate:917, Flush:61, Flush:62, Mate:934, Mate:935, Mate:936, Mate:937, Mate:938, Mate:939, Mate:940, Mate:941, Mate:942, Mate:944, Mate:946, Mate:948, Mate:954, Mate:955, Mate:956, Mate:957
64. ASSEMBLY_PCB_SERVO_CONN:1 [sub-assembly] — Mate:909, Mate:910, Mate:911, Mate:918, Mate:919, Mate:920, Mate:921, Mate:922, Mate:923, Mate:924, Mate:925
65. 3DP_PLA_Electronics_Box_Top_REVB:1 — Mate:917, Flush:61, Flush:62, Mate:943, Mate:945, Mate:947, Mate:949, Mate:950, Mate:951, Mate:952, Mate:953
66. COTS_MKS_Canable_2_0:1 — Mate:912, Mate:913, Mate:914, Mate:926, Mate:927, Mate:928, Mate:929, Mate:930, Mate:931, Mate:932, Mate:933
67. COTS_BYTECHLAB_Coaxial_Feed_Horn:1 [sub-assembly] — Mate:520, Mate:521, Mate:522
68. 3DP_PLA_Antenna_Boom_Coax_Feed_Horn_REVB:1 — Mate:500, Mate:501, Flush:22, Flush:23, Mate:504, Mate:505, Mate:506, Mate:507, Mate:508, Mate:509, Mate:510, Mate:511, Mate:520, Mate:521, Mate:522
69. COTS_BYTECHLAB_Dual_Ridged_Horn:1 [sub-assembly] — Mate:959, Mate:960, Mate:961
70. 3DP_PLA_Antenna_Boom_Dual_Ridged_Horn_3DP_REVB:1 — Mate:958, Flush:63, Flush:64, Mate:959, Mate:960, Mate:961
71. 3DP_PLA_Antenna_Boom_High_Frequency_Biconical_REVB:1 — Mate:962, Flush:65, Flush:66, Mate:963, Mate:964
72. COTS_BYTECHLAB_High_Freq_Biconical:1 [sub-assembly] — Mate:963, Mate:964
73. COTS_BYTECHLAB_Microstrip_Patch_Array:1 [sub-assembly] — Mate:966, Mate:967
74. 3DP_PLA_Antenna_Boom_Microstrip_Patch_Array_REVB:1 — Flush:67, Flush:68, Mate:965, Mate:966, Mate:967
75. COTS_BYTECHLAB_2_4_GHz_2x2_Phased_Array:1 [sub-assembly] — Mate:969, Mate:970, Angle:75
76. 3DP_PLA_Antenna_Boom_2_4GHz_2x2_Phased_Array_REVB:1 — Mate:968, Flush:69, Flush:70, Mate:969, Mate:970, Angle:75
77. COTS_BYTECHLAB_Log_Periodic:1 [sub-assembly] — Mate:972, Mate:973, Flush:73
78. 3DP_PLA_Antenna_Boom_Log_Periodic_REVB:1 — Mate:971, Flush:71, Flush:72, Mate:972, Mate:973, Flush:73, Mate:974, Mate:975, Mate:976
79. 3DP_PLA_Antenna_Boom_Log_Periodic_Clamp_REVB:1 — Mate:974, Mate:975, Mate:976
80. COTS_BYTECHLAB_Antipodal_Vivaldi:1 [sub-assembly] — Mate:978, Mate:979, Mate:980
81. 3DP_PLA_Antenna_Boom_Antipodal_Vivaldi_REVB:1 — Mate:977, Flush:74, Flush:75, Mate:978, Mate:979, Mate:980, Mate:981, Mate:982, Mate:983
82. 3DP_PLA_Antenna_Boom_Clamp_Antipodal_Vivaldi_REVB:1 — Mate:981, Mate:982, Mate:983
83. DIN 912 - replaced by DIN EN ISO 4762 M3 x 8:4 — Mate:956, Mate:957
84. DIN 912 - replaced by DIN EN ISO 4762 M3 x 8:3 — Mate:954, Mate:955
85. DIN 912 - replaced by DIN EN ISO 4762 M3 x 8:2 — Mate:952, Mate:953
86. DIN 912 - replaced by DIN EN ISO 4762 M3 x 8:1 — Mate:950, Mate:951
87. DIN 934 - replaced by DIN EN 24032/28673/28674 M3:4 — Mate:948, Mate:949
88. DIN 934 - replaced by DIN EN 24032/28673/28674 M3:3 — Mate:946, Mate:947
89. DIN 934 - replaced by DIN EN 24032/28673/28674 M3:2 — Mate:944, Mate:945
90. DIN 912 - replaced by DIN EN ISO 4762 M3 x 30:4 — Mate:940, Mate:941
91. DIN 912 - replaced by DIN EN ISO 4762 M3 x 30:3 — Mate:938, Mate:939
92. DIN 912 - replaced by DIN EN ISO 4762 M3 x 30:2 — Mate:936, Mate:937
93. DIN 934 - replaced by DIN EN 24032/28673/28674 M3:1 — Mate:942, Mate:943
94. DIN 912 - replaced by DIN EN ISO 4762 M3 x 30:1 — Mate:934, Mate:935
95. DIN 912 - replaced by DIN EN ISO 4762 M2 x 6:4 — Mate:932, Mate:933
96. DIN 912 - replaced by DIN EN ISO 4762 M2 x 6:3 — Mate:930, Mate:931
97. DIN 912 - replaced by DIN EN ISO 4762 M2 x 6:2 — Mate:928, Mate:929
98. DIN 912 - replaced by DIN EN ISO 4762 M2 x 6:1 — Mate:926, Mate:927
99. ISO 7380-1 M3 x 6:4 — Mate:924, Mate:925
100. ISO 7380-1 M3 x 6:3 — Mate:922, Mate:923
101. ISO 7380-1 M3 x 6:2 — Mate:920, Mate:921
102. ISO 7380-1 M3 x 6:1 — Mate:918, Mate:919
103. DIN 912 - replaced by DIN EN ISO 4762 M4 x 10:23 — Insert:53
104. DIN 912 - replaced by DIN EN ISO 4762 M4 x 10:22 — Insert:52
105. DIN 912 - replaced by DIN EN ISO 4762 M4 x 10:21 — Insert:51
106. DIN 125-1 A A 4,3:42 — Mate:888, Mate:889, Insert:53
107. DIN 125-1 A A 4,3:41 — Mate:886, Mate:887, Insert:52
108. DIN 125-1 A A 4,3:40 — Mate:884, Mate:885, Insert:51
109. DIN 912 - replaced by DIN EN ISO 4762 M4 x 10:20 — Insert:50
110. DIN 125-1 A A 4,3:39 — Mate:882, Mate:883, Insert:50
111. DIN 912 - replaced by DIN EN ISO 4762 M4 x 10:7 — Mate:853, Mate:854
112. DIN 912 - replaced by DIN EN ISO 4762 M4 x 10:6 — Mate:851, Mate:852
113. DIN 912 - replaced by DIN EN ISO 4762 M4 x 10:5 — Mate:849, Mate:850
114. DIN 912 - replaced by DIN EN ISO 4762 M4 x 10:4 — Mate:847, Mate:848
115. DIN 934 - replaced by DIN EN 24032/28673/28674 M4:32 — Insert:43
116. DIN 934 - replaced by DIN EN 24032/28673/28674 M4:31 — Insert:42
117. DIN 934 - replaced by DIN EN 24032/28673/28674 M4:30 — Insert:41
118. DIN 125-1 A A 4,3:20 — Mate:845, Mate:846, Insert:43
119. DIN 125-1 A A 4,3:19 — Mate:843, Mate:844, Insert:42
120. DIN 125-1 A A 4,3:18 — Mate:841, Mate:842, Insert:41
121. DIN 912 - replaced by DIN EN ISO 4762 M4 x 20:12 — Insert:39
122. DIN 912 - replaced by DIN EN ISO 4762 M4 x 20:11 — Insert:38
123. DIN 912 - replaced by DIN EN ISO 4762 M4 x 20:10 — Insert:37
124. DIN 125-1 A A 4,3:17 — Mate:837, Mate:838, Insert:39
125. DIN 125-1 A A 4,3:16 — Mate:835, Mate:836, Insert:38
126. DIN 125-1 A A 4,3:15 — Mate:833, Mate:834, Insert:37
127. DIN 934 - replaced by DIN EN 24032/28673/28674 M4:29 — Insert:40
128. DIN 125-1 A A 4,3:14 — Mate:839, Mate:840, Insert:40
129. DIN 912 - replaced by DIN EN ISO 4762 M4 x 20:9 — Insert:36
130. DIN 125-1 A A 4,3:13 — Mate:831, Mate:832, Insert:36
131. DIN 934 - replaced by DIN EN 24032/28673/28674 M5:35 — Mate:766, Mate:767
132. DIN 934 - replaced by DIN EN 24032/28673/28674 M5:34 — Mate:764, Mate:765
133. DIN 934 - replaced by DIN EN 24032/28673/28674 M5:33 — Mate:762, Mate:763
134. DIN 934 - replaced by DIN EN 24032/28673/28674 M5:32 — Mate:760, Mate:761
135. DIN 934 - replaced by DIN EN 24032/28673/28674 M5:31 — Mate:758, Mate:759
136. DIN 934 - replaced by DIN EN 24032/28673/28674 M5:30 — Mate:756, Mate:757
137. DIN 934 - replaced by DIN EN 24032/28673/28674 M5:29 — Mate:754, Mate:755
138. DIN 934 - replaced by DIN EN 24032/28673/28674 M5:28 — Mate:752, Mate:753
139. DIN 912 - replaced by DIN EN ISO 4762 M5 x 30:15 — Insert:26
140. DIN 912 - replaced by DIN EN ISO 4762 M5 x 30:14 — Insert:25
141. DIN 912 - replaced by DIN EN ISO 4762 M5 x 30:13 — Insert:24
142. DIN 912 - replaced by DIN EN ISO 4762 M5 x 30:12 — Insert:23
143. DIN 912 - replaced by DIN EN ISO 4762 M5 x 30:11 — Insert:22
144. DIN 912 - replaced by DIN EN ISO 4762 M5 x 30:10 — Insert:21
145. DIN 912 - replaced by DIN EN ISO 4762 M5 x 30:9 — Insert:20
146. DIN 912 - replaced by DIN EN ISO 4762 M5 x 30:8 — Insert:19
147. DIN 125-1 A A 5,3:15 — Mate:748, Mate:749, Insert:26
148. DIN 125-1 A A 5,3:14 — Mate:746, Mate:747, Insert:25
149. DIN 125-1 A A 5,3:13 — Mate:744, Mate:745, Insert:24
150. DIN 125-1 A A 5,3:12 — Mate:742, Mate:743, Insert:23
151. DIN 125-1 A A 5,3:11 — Mate:740, Mate:741, Insert:22
152. DIN 125-1 A A 5,3:10 — Mate:738, Mate:739, Insert:21
153. DIN 125-1 A A 5,3:9 — Mate:736, Mate:737, Insert:20
154. DIN 125-1 A A 5,3:8 — Mate:734, Mate:735, Insert:19
155. DIN 934 - replaced by DIN EN 24032/28673/28674 M5:27 — Mate:750, Mate:751
156. DIN 912 - replaced by DIN EN ISO 4762 M5 x 30:7 — Insert:18
157. DIN 125-1 A A 5,3:7 — Mate:732, Mate:733, Insert:18
158. DIN 934 - replaced by DIN EN 24032/28673/28674 M5:41 — Mate:804, Mate:805
159. DIN 934 - replaced by DIN EN 24032/28673/28674 M5:40 — Mate:802, Mate:803
160. DIN 934 - replaced by DIN EN 24032/28673/28674 M5:39 — Mate:800, Mate:801
161. DIN 934 - replaced by DIN EN 24032/28673/28674 M5:38 — Mate:798, Mate:799
162. DIN 934 - replaced by DIN EN 24032/28673/28674 M5:37 — Mate:796, Mate:797
163. DIN 912 - replaced by DIN EN ISO 4762 M5 x 30:21 — Insert:35
164. DIN 912 - replaced by DIN EN ISO 4762 M5 x 30:20 — Insert:34
165. DIN 912 - replaced by DIN EN ISO 4762 M5 x 30:19 — Insert:33
166. DIN 912 - replaced by DIN EN ISO 4762 M5 x 30:18 — Insert:32
167. DIN 912 - replaced by DIN EN ISO 4762 M5 x 30:17 — Insert:31
168. DIN 125-1 A A 5,3:21 — Mate:792, Mate:793, Insert:35
169. DIN 125-1 A A 5,3:20 — Mate:790, Mate:791, Insert:34
170. DIN 125-1 A A 5,3:19 — Mate:788, Mate:789, Insert:33
171. DIN 125-1 A A 5,3:18 — Mate:786, Mate:787, Insert:32
172. DIN 125-1 A A 5,3:17 — Mate:784, Mate:785, Insert:31
173. DIN 934 - replaced by DIN EN 24032/28673/28674 M5:36 — Mate:794, Mate:795
174. DIN 912 - replaced by DIN EN ISO 4762 M5 x 30:16 — Insert:30
175. DIN 125-1 A A 5,3:16 — Mate:782, Mate:783, Insert:30
176. DIN 912 - replaced by DIN EN ISO 4762 M4 x 35:3 — Mate:595, Mate:596
177. DIN 934 - replaced by DIN EN 24032/28673/28674 M4:25 — Mate:599, Mate:600
178. DIN 912 - replaced by DIN EN ISO 4762 M4 x 35:4 — Mate:597, Mate:598
179. DIN 934 - replaced by DIN EN 24032/28673/28674 M4:26 — Mate:601, Mate:602
180. ISO 7380-1 M4 x 40:12 — Mate:606, Mate:607
181. DIN 934 - replaced by DIN EN 24032/28673/28674 M4:27 — Mate:610, Mate:611
182. ISO 7380-1 M4 x 40:13 — Mate:608, Mate:609
183. DIN 934 - replaced by DIN EN 24032/28673/28674 M4:28 — Mate:612, Mate:613
184. COTS_BOSSARD_1386883_M4_Threaded_Insert:1 — Mate:577, Flush:24, Mate:578
185. DIN 125-1 A A 4,3:1 — Mate:579, Mate:580, Insert:9
186. ISO 7380-1 M4 x 8:1 — Insert:9
187. DIN 125-1 A A 4,3:2 — Mate:582, Mate:583, Insert:10
188. ISO 7380-1 M4 x 16:1 — Insert:10
189. DIN 125-1 A A 4,3:3 — Mate:584, Mate:585, Insert:11
190. DIN 934 - replaced by DIN EN 24032/28673/28674 M4:24 — Insert:11
191. COTS_BOSSARD_1400444_M6_Nylon_Nut:66 — Mate:513, Mate:517
192. COTS_BOSSARD_1400444_M6_Nylon_Nut:65 — Mate:514, Mate:519
193. COTS_BOSSARD_1400444_M6_Nylon_Nut:64 — Mate:515, Mate:516
194. COTS_BOSSARD_1400444_M6_Nylon_Nut:63 — Mate:512, Mate:518
195. COTS_DREMEC_8G206M6X50_M6x50_Nylon_Screw:66 — Mate:507, Mate:508, Mate:516
196. COTS_DREMEC_8G206M6X50_M6x50_Nylon_Screw:65 — Mate:506, Mate:511, Mate:519
197. COTS_DREMEC_8G206M6X50_M6x50_Nylon_Screw:64 — Mate:505, Mate:509, Mate:517
198. COTS_DREMEC_8G206M6X50_M6x50_Nylon_Screw:63 — Mate:504, Mate:510, Mate:518